# Autodesk Inventor assembly: BG003_thutrn22_26
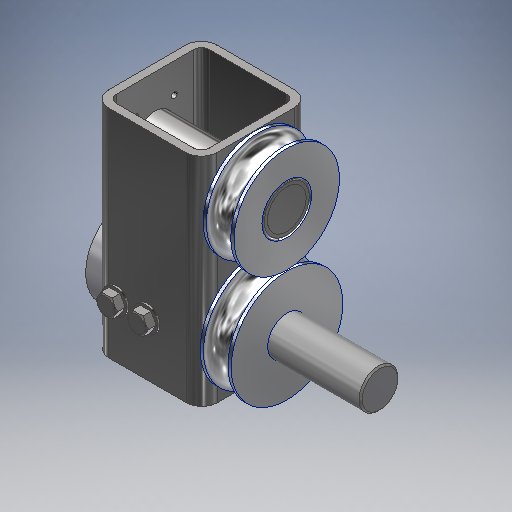
[picture p0: Inventor's stored thumbnail of the model, 512x512]
Saved by Autodesk Inventor 2025.3 (Build 293356000, 356)
## iProperties
Company: HTBLA Kaindorf
RuleStatus: InUse
Created: 2026-08-11
Part Number: BG003_thutrn22_26
Project: Biegeroboter
Material: Generisch
Description: verlängerung_gesamt_v2
Document SubType Name: Assembly
Designer: thutrn22
Mass: 2233.48 g
Surface Area: 1625.46 cm^2
Volume: 501.725 cm^3
Density: 4.4516 g/cm^3
AfterDocNew0: iProperties-Editor_aufrufen
Author: trist
Keywords: 2026
## Documents named in this file (11)
- C:\Users\trist\Desktop\Schule\diplomarbeit_dateien\Mechanik\Biegekopf\Verlängerung\BG003_thutrn22_26_Biegeroboter_verlängerung_gesamt_v2.iam
- C:\Users\trist\Desktop\Schule\diplomarbeit_dateien\Mechanik\Biegekopf\Verlängerung\BT007_bensen22_26_Biegeroboter_verlängerung_aufnahme_v1.ipt
- C:\Users\trist\Desktop\Schule\diplomarbeit_dateien\Mechanik\Biegekopf\Verlängerung\BT009_bensen22_26_Biegeroboter_verlängerung_bolzen_v1.ipt
- C:\Users\trist\Desktop\Schule\diplomarbeit_dateien\Mechanik\Biegekopf\Bolzen\Bolzen\Bolzen.ipt
- C:\Users\trist\Desktop\Schule\diplomarbeit_dateien\Mechanik\Biegerolle\BT009_thutrn22_26_Biegeroboter_biegerolle_v1.ipt
- C:\Users\trist\Documents\Inventor\Content Center Files\R2025\de-DE\BS 290 SKF(30)\BS 290 SKF - SKF 6205.ipt
- C:\Users\trist\Documents\Inventor\Content Center Files\R2025\de-DE\DIN 618 - T1  HK\DIN 618 - HK2520 - 25 x 32 x 20.ipt
- C:\Users\trist\Desktop\Schule\diplomarbeit_dateien\Mechanik\Biegekopf\Verlängerung\BT011_thutrn22_26_Biegeroboter_Nadellager.ipt
- C:\Users\trist\Documents\Inventor\Content Center Files\R2025\de-DE\AS 1110\AS 1110 - M3 x 6.ipt
- C:\Users\trist\Desktop\Schule\diplomarbeit_dateien\Mechanik\Biegekopf\Verlängerung\DIN EN 10219-2 - 70 x 70 x 5  - 120.ipt
- C:\Users\trist\Documents\Inventor\Content Center Files\R2025\de-DE\AS 1427(00)\AS 1427 - M8 x 16(4).ipt
## Components (16 placed, 10 different names)
1. BT007_bensen22_26_Biegeroboter_verlängerung_aufnahme_v1:1 — Passend:2, Passend:3, Passend:4, Passend:5, Passend:7, Passend:9
2. BT009_bensen22_26_Biegeroboter_verlängerung_bolzen_v1:1 — Einfügen:2, Einfügen:3, Einfügen:4, Einfügen:5, Passend:11, Passend:13
3. Bolzen:1 — Passend:2, Passend:3, Passend:6
4. BT009_thutrn22_26_Biegeroboter_biegerolle_v1:1 — Passend:6, Passend:7, Passend:10
5. BS 290 SKF 6205:1 — Passend:4, Passend:5
6. DIN 618 - T1 HK HK2520 - 25 x 32 x 20:1 — Passend:14, Fluchtend:1, Einfügen:6
7. BT011_thutrn22_26_Biegeroboter_Nadellager:1 — Passend:14, Fluchtend:1
8. AS 1110 - Metrisch M3 x 6:1 — Einfügen:2
9. AS 1110 - Metrisch M3 x 6:2 — Einfügen:3
10. AS 1110 - Metrisch M3 x 6:3 — Einfügen:4, Passend:12
11. AS 1110 - Metrisch M3 x 6:4 — Einfügen:5
12. DIN EN 10219-2 - 70 x 70 x 5  - 120:1 — Passend:9, Passend:10, Passend:11, Passend:12, Passend:13, Einfügen:6, Einfügen:7, Einfügen:8, Einfügen:9, Einfügen:10
13. AS 1427 - Metrisch M8 x 16:1 — Einfügen:8
14. AS 1427 - Metrisch M8 x 16:2 — Einfügen:9
15. AS 1427 - Metrisch M8 x 16:3 — Einfügen:7
16. AS 1427 - Metrisch M8 x 16:4 — Einfügen:10
## Relationships (22: Mate 12, Insert 9, Flush 1)
- Passend:2 [Mate]: BT007_bensen22_26_Biegeroboter_verlängerung_aufnahme_v1:1 ↔ Bolzen:1
- Passend:3 [Mate]: BT007_bensen22_26_Biegeroboter_verlängerung_aufnahme_v1:1 ↔ Bolzen:1
- Passend:4 [Mate]: BT007_bensen22_26_Biegeroboter_verlängerung_aufnahme_v1:1 ↔ BS 290 SKF 6205:1
- Passend:5 [Mate]: BT007_bensen22_26_Biegeroboter_verlängerung_aufnahme_v1:1 ↔ BS 290 SKF 6205:1
- Passend:6 [Mate]: Bolzen:1 ↔ BT009_thutrn22_26_Biegeroboter_biegerolle_v1:1
- Passend:7 [Mate]: BT007_bensen22_26_Biegeroboter_verlängerung_aufnahme_v1:1 ↔ BT009_thutrn22_26_Biegeroboter_biegerolle_v1:1
- Einfügen:2 [Insert]: BT009_bensen22_26_Biegeroboter_verlängerung_bolzen_v1:1 ↔ AS 1110 - Metrisch M3 x 6:1
- Einfügen:3 [Insert]: BT009_bensen22_26_Biegeroboter_verlängerung_bolzen_v1:1 ↔ AS 1110 - Metrisch M3 x 6:2
- Einfügen:4 [Insert]: BT009_bensen22_26_Biegeroboter_verlängerung_bolzen_v1:1 ↔ AS 1110 - Metrisch M3 x 6:3
- Einfügen:5 [Insert]: BT009_bensen22_26_Biegeroboter_verlängerung_bolzen_v1:1 ↔ AS 1110 - Metrisch M3 x 6:4
- Passend:9 [Mate]: BT007_bensen22_26_Biegeroboter_verlängerung_aufnahme_v1:1 ↔ DIN EN 10219-2 - 70 x 70 x 5  - 120:1
- Passend:10 [Mate]: BT009_thutrn22_26_Biegeroboter_biegerolle_v1:1 ↔ DIN EN 10219-2 - 70 x 70 x 5  - 120:1
- Passend:11 [Mate]: BT009_bensen22_26_Biegeroboter_verlängerung_bolzen_v1:1 ↔ DIN EN 10219-2 - 70 x 70 x 5  - 120:1
- Passend:12 [Mate]: AS 1110 - Metrisch M3 x 6:3 ↔ DIN EN 10219-2 - 70 x 70 x 5  - 120:1
- Passend:13 [Mate]: BT009_bensen22_26_Biegeroboter_verlängerung_bolzen_v1:1 ↔ DIN EN 10219-2 - 70 x 70 x 5  - 120:1
- Passend:14 [Mate]: DIN 618 - T1 HK HK2520 - 25 x 32 x 20:1 ↔ BT011_thutrn22_26_Biegeroboter_Nadellager:1
- Fluchtend:1 [Flush]: DIN 618 - T1 HK HK2520 - 25 x 32 x 20:1 ↔ BT011_thutrn22_26_Biegeroboter_Nadellager:1
- Einfügen:6 [Insert]: DIN 618 - T1 HK HK2520 - 25 x 32 x 20:1 ↔ DIN EN 10219-2 - 70 x 70 x 5  - 120:1
- Einfügen:7 [Insert]: DIN EN 10219-2 - 70 x 70 x 5  - 120:1 ↔ AS 1427 - Metrisch M8 x 16:3
- Einfügen:8 [Insert]: DIN EN 10219-2 - 70 x 70 x 5  - 120:1 ↔ AS 1427 - Metrisch M8 x 16:1
- Einfügen:9 [Insert]: DIN EN 10219-2 - 70 x 70 x 5  - 120:1 ↔ AS 1427 - Metrisch M8 x 16:2
- Einfügen:10 [Insert]: DIN EN 10219-2 - 70 x 70 x 5  - 120:1 ↔ AS 1427 - Metrisch M8 x 16:4
